# Autodesk Inventor assembly: Assembly_capstone
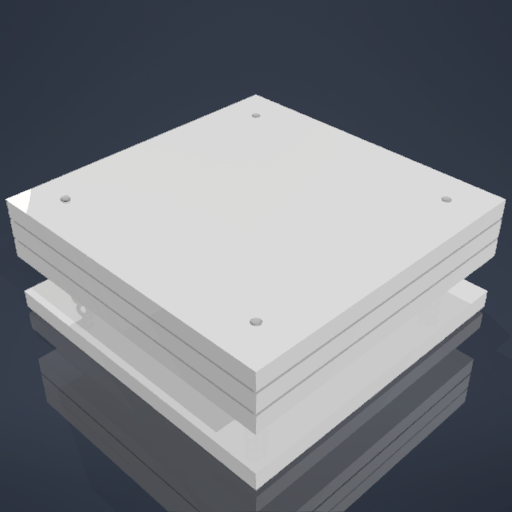
[picture p0: Inventor's stored thumbnail of the model, 512x512]
Saved by Autodesk Inventor 2026 (Build 300175000, 175)
## iProperties
Created: 2025-12-18
Part Number: Assembly_capstone
Document SubType Name: Assembly
Designer: MSI NOTEBOOK
Author: MSI NOTEBOOK
## Documents named in this file (4)
- C:\Kuliah\semester 7\CAPS\Assembly_capstone.iam
- C:\Kuliah\semester 7\CAPS\Part2.ipt
- C:\Kuliah\semester 7\CAPS\Part3.ipt
- C:\Kuliah\semester 7\CAPS\Part4.ipt
## Components (9 placed, 3 different names)
1. Part3:1 — Mate:1, Mate:9
2. Part3:2 — Mate:2, Mate:7, Mate:11
3. Part3:3 — Mate:3, Mate:6, Mate:15
4. Part3:4 — Mate:4, Mate:5, Mate:13
5. Part4:1 — Mate:10, Mate:11
6. Part4:2 — Mate:12, Mate:13
7. Part4:3 — Mate:14, Mate:15
8. Part4:4 — Mate:8, Mate:9
9. Part2:1 — Mate:1, Mate:2, Mate:3, Mate:4, Mate:5, Mate:6, Mate:7, Mate:8, Mate:10, Mate:12, Mate:14
## Relationships (15: Mate 15)
- Mate:1: Part3:1 ↔ Part2:1
- Mate:2: Part3:2 ↔ Part2:1
- Mate:3: Part3:3 ↔ Part2:1
- Mate:4: Part3:4 ↔ Part2:1
- Mate:5: Part3:4 ↔ Part2:1
- Mate:6: Part3:3 ↔ Part2:1
- Mate:7: Part3:2 ↔ Part2:1
- Mate:8: Part4:4 ↔ Part2:1
- Mate:9: Part3:1 ↔ Part4:4
- Mate:10: Part4:1 ↔ Part2:1
- Mate:11: Part3:2 ↔ Part4:1
- Mate:12: Part4:2 ↔ Part2:1
- Mate:13: Part3:4 ↔ Part4:2
- Mate:14: Part4:3 ↔ Part2:1
- Mate:15: Part3:3 ↔ Part4:3
